# Autodesk Inventor assembly: underwater_drone_assembly
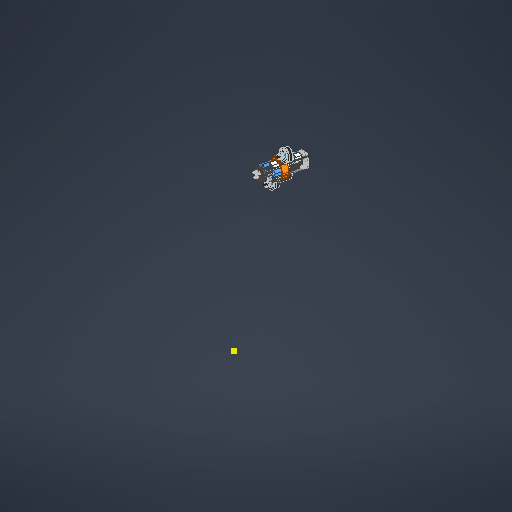
[picture p0: Inventor's stored thumbnail of the model, 512x512]
Saved by Autodesk Inventor 2026.2 (Build 302298010, 298A)
## iProperties
Created: 2026-10-25
Part Number: underwater_drone_assembly
Document SubType Name: Assembly
Designer: User
L_main_hull: 300,000 mm
D_int_main_hull: 4,000 po
D_ext_main_hull: 109,600 mm
t_main_hull: 4,000 mm
Author: User
## Documents named in this file (16)
- D:\Documents\Tibo\ECOLE\NTUST\Intelligent_Control_Systems\Underwater_swarm_project\hardware\CAD_underwater_swarm_project\underwater_drone_assembly.iam
- D:\Documents\Tibo\ECOLE\NTUST\Intelligent_Control_Systems\Underwater_swarm_project\hardware\CAD_underwater_swarm_project\hull\back_lid.ipt
- D:\Documents\Tibo\ECOLE\NTUST\Intelligent_Control_Systems\Underwater_swarm_project\hardware\CAD_underwater_swarm_project\hull\main_hull.ipt
- D:\Documents\Tibo\ECOLE\NTUST\Intelligent_Control_Systems\Underwater_swarm_project\hardware\CAD_underwater_swarm_project\batteries\battery_power.ipt
- D:\Documents\Tibo\ECOLE\NTUST\Intelligent_Control_Systems\Underwater_swarm_project\hardware\CAD_underwater_swarm_project\internal_frame\stepper_motor_support.ipt
- D:\Documents\Tibo\ECOLE\NTUST\Intelligent_Control_Systems\Underwater_swarm_project\hardware\CAD_underwater_swarm_project\batteries\battery_control.ipt
- D:\Documents\Tibo\ECOLE\NTUST\Intelligent_Control_Systems\Underwater_swarm_project\hardware\CAD_underwater_swarm_project\external_frame\thruster_adapter_2.ipt
- D:\Documents\Tibo\ECOLE\NTUST\Intelligent_Control_Systems\Underwater_swarm_project\hardware\CAD_underwater_swarm_project\external_frame\clamp_anterior_superior.ipt
- D:\Documents\Tibo\ECOLE\NTUST\Intelligent_Control_Systems\Underwater_swarm_project\hardware\CAD_underwater_swarm_project\external_frame\clamp_anterior_inferior.ipt
- D:\Documents\Tibo\ECOLE\NTUST\Intelligent_Control_Systems\Underwater_swarm_project\hardware\CAD_underwater_swarm_project\hull\front_lid.ipt
- D:\Documents\Tibo\ECOLE\NTUST\Intelligent_Control_Systems\Underwater_swarm_project\hardware\CAD_underwater_swarm_project\hull\front_window.ipt
- D:\Documents\Tibo\ECOLE\NTUST\Intelligent_Control_Systems\Underwater_swarm_project\hardware\CAD_underwater_swarm_project\external_frame\handle.ipt
- D:\Documents\Tibo\ECOLE\NTUST\Intelligent_Control_Systems\Underwater_swarm_project\hardware\CAD_underwater_swarm_project\external_frame\depth_sensor_support.ipt
- D:\Documents\Tibo\ECOLE\NTUST\Intelligent_Control_Systems\Underwater_swarm_project\hardware\CAD_underwater_swarm_project\external_frame\stick_2.ipt
- D:\Documents\Tibo\ECOLE\NTUST\Intelligent_Control_Systems\Underwater_swarm_project\hardware\CAD_underwater_swarm_project\hull\gland_m12.ipt
- D:\Documents\Tibo\ECOLE\NTUST\Intelligent_Control_Systems\Underwater_swarm_project\hardware\CAD_underwater_swarm_project\external_frame\T200-ASM-CW-THRUSTER-R1.ipt
## Components (20 placed, 15 different names)
1. back_lid:1 — Placage:32, Placage:33
2. main_hull:1 — Placage:5, Placage:32, Placage:33, Placage:34, Placage:35, Placage:46
3. battery_power:1 — Placage:7, Placage:8, Placage:37, Placage:42
4. stepper_motor_support:1 — Placage:5, Placage:7, Placage:8, Placage:22, Placage:23, Placage:36, Placage:37, Placage:53, Placage:56, Placage:57, Placage:58, Placage:59, Placage:60, Placage:61
5. battery_control:1 — Placage:22, Placage:23, Placage:42
6. thruster_adapter_2:1 — Placage:13, Placage:14, Affleurement:3, Placage:63, Placage:64
7. thruster_adapter_2:2 — Placage:11, Placage:12, Affleurement:17, Placage:62, Placage:65
8. clamp_anterior_superior:1 — Placage:11, Placage:12, Placage:13, Placage:14, Affleurement:3, Placage:15, Placage:16, Placage:26, Placage:27, Placage:28, Affleurement:17, Placage:46, Placage:47, Placage:48, Placage:51, Placage:52, Affleurement:18
9. clamp_anterior_inferior:1 — Placage:15, Placage:16, Affleurement:18
10. front_lid:1 — Placage:21, Placage:31, Placage:34, Placage:35, Placage:36, Placage:53, Placage:54, Placage:55
11. front_window:1 — Placage:21, Placage:31
12. handle:1 — Placage:26, Placage:27, Placage:28, Placage:43, Placage:44, Placage:45
13. depth_sensor_support:1 — Placage:43, Placage:44, Placage:45
14. stick_2:1 — Placage:51, Placage:52, Placage:54
15. stick_2:2 — Placage:47, Placage:48, Placage:55
16. gland_m12:1 — Placage:56, Placage:60
17. gland_m12:2 — Placage:58, Placage:61
18. gland_m12:3 — Placage:57, Placage:59
19. T200-ASM-CW-THRUSTER-R1:1 — Placage:62, Placage:65
20. T200-ASM-CW-THRUSTER-R1:2 — Placage:63, Placage:64
## Relationships (47: Mate 44, Flush 3)
- Placage:5 [Mate]: main_hull:1 ↔ stepper_motor_support:1
- Placage:7 [Mate]: battery_power:1 ↔ stepper_motor_support:1
- Placage:8 [Mate]: battery_power:1 ↔ stepper_motor_support:1
- Placage:11 [Mate]: thruster_adapter_2:2 ↔ clamp_anterior_superior:1
- Placage:12 [Mate]: thruster_adapter_2:2 ↔ clamp_anterior_superior:1
- Placage:13 [Mate]: thruster_adapter_2:1 ↔ clamp_anterior_superior:1
- Placage:14 [Mate]: thruster_adapter_2:1 ↔ clamp_anterior_superior:1
- Affleurement:3 [Flush]: thruster_adapter_2:1 ↔ clamp_anterior_superior:1
- Placage:15 [Mate] (5 mm): clamp_anterior_superior:1 ↔ clamp_anterior_inferior:1
- Placage:16 [Mate]: clamp_anterior_superior:1 ↔ clamp_anterior_inferior:1
- Placage:21 [Mate]: front_lid:1 ↔ front_window:1
- Placage:22 [Mate] (15 mm): stepper_motor_support:1 ↔ battery_control:1
- Placage:23 [Mate] (6 mm): stepper_motor_support:1 ↔ battery_control:1
- Placage:26 [Mate]: clamp_anterior_superior:1 ↔ handle:1
- Placage:27 [Mate]: clamp_anterior_superior:1 ↔ handle:1
- Placage:28 [Mate]: clamp_anterior_superior:1 ↔ handle:1
- Affleurement:17 [Flush]: thruster_adapter_2:2 ↔ clamp_anterior_superior:1
- Placage:31 [Mate]: front_lid:1 ↔ front_window:1
- Placage:32 [Mate]: back_lid:1 ↔ main_hull:1
- Placage:33 [Mate]: back_lid:1 ↔ main_hull:1
- Placage:34 [Mate]: main_hull:1 ↔ front_lid:1
- Placage:35 [Mate]: main_hull:1 ↔ front_lid:1
- Placage:36 [Mate]: stepper_motor_support:1 ↔ front_lid:1
- Placage:37 [Mate]: battery_power:1 ↔ stepper_motor_support:1
- Placage:42 [Mate]: battery_power:1 ↔ battery_control:1
- Placage:43 [Mate]: handle:1 ↔ depth_sensor_support:1
- Placage:44 [Mate]: handle:1 ↔ depth_sensor_support:1
- Placage:45 [Mate]: handle:1 ↔ depth_sensor_support:1
- Placage:46 [Mate]: main_hull:1 ↔ clamp_anterior_superior:1
- Placage:47 [Mate]: clamp_anterior_superior:1 ↔ stick_2:2
- Placage:48 [Mate]: clamp_anterior_superior:1 ↔ stick_2:2
- Placage:51 [Mate]: clamp_anterior_superior:1 ↔ stick_2:1
- Placage:52 [Mate]: clamp_anterior_superior:1 ↔ stick_2:1
- Affleurement:18 [Flush]: clamp_anterior_superior:1 ↔ clamp_anterior_inferior:1
- Placage:53 [Mate] (0.1 mm): stepper_motor_support:1 ↔ front_lid:1
- Placage:54 [Mate]: front_lid:1 ↔ stick_2:1
- Placage:55 [Mate]: front_lid:1 ↔ stick_2:2
- Placage:56 [Mate]: stepper_motor_support:1 ↔ gland_m12:1
- Placage:57 [Mate]: stepper_motor_support:1 ↔ gland_m12:3
- Placage:58 [Mate]: stepper_motor_support:1 ↔ gland_m12:2
- Placage:59 [Mate]: stepper_motor_support:1 ↔ gland_m12:3
- Placage:60 [Mate]: stepper_motor_support:1 ↔ gland_m12:1
- Placage:61 [Mate]: stepper_motor_support:1 ↔ gland_m12:2
- Placage:62 [Mate]: thruster_adapter_2:2 ↔ T200-ASM-CW-THRUSTER-R1:1
- Placage:63 [Mate]: thruster_adapter_2:1 ↔ T200-ASM-CW-THRUSTER-R1:2
- Placage:64 [Mate]: thruster_adapter_2:1 ↔ T200-ASM-CW-THRUSTER-R1:2
- Placage:65 [Mate]: thruster_adapter_2:2 ↔ T200-ASM-CW-THRUSTER-R1:1
## Named parameters: L_main_hull = 300 mm, D_int_main_hull = 101.6 mm, D_ext_main_hull = 109.6 mm, t_main_hull = 4 mm
